# Autodesk Inventor assembly: MontagemCanhao
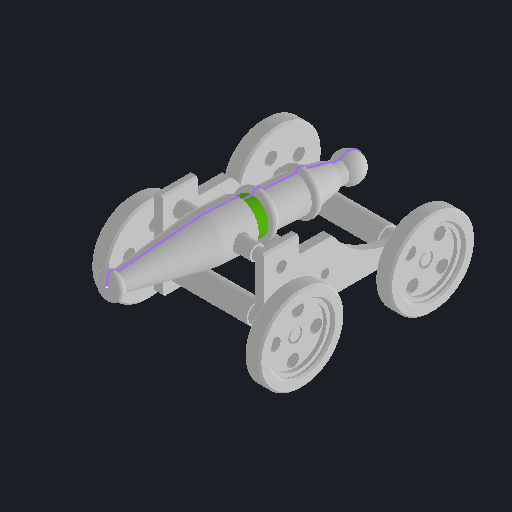
[picture p0: Inventor's stored thumbnail of the model, 512x512]
Saved by Autodesk Inventor 2027 (Build 310192060, 192F)
## iProperties
Created: 2026-11-08
Part Number: MontagemCanhao
Document SubType Name: Assembly
Designer: Giovanna Oliveira
Author: Giovanna Oliveira
## Documents named in this file (6)
- E:\IFSP\engMec\2Sem\DESENHOASSITIDO\Canhao\MontagemCanhao.iam
- E:\IFSP\engMec\2Sem\DESENHOASSITIDO\Canhao\Placa.ipt
- E:\IFSP\engMec\2Sem\DESENHOASSITIDO\Canhao\Peça3.ipt
- E:\IFSP\engMec\2Sem\DESENHOASSITIDO\Canhao\Eixo5.ipt
- C:\Users\Giovanna Oliveira\Downloads\canhazinho (1).ipt
- E:\IFSP\engMec\2Sem\DESENHOASSITIDO\Canhao\Roda.ipt
## Components (11 placed, 5 different names)
1. Placa:1 — Coincidente:1, Coincidente:2, Coincidente:3, Coincidente:4, Coincidente:7, Coincidente:8, Coincidente:9, Coincidente:10, Coincidente:12
2. Peça3:1 — Coincidente:1, Coincidente:3, Coincidente:13, Coincidente:14, Coincidente:16, Coincidente:17, Alinhado:1, Coincidente:19, Alinhado:3
3. Peça3:2 — Coincidente:2, Coincidente:4, Coincidente:15, Coincidente:18, Alinhado:2, Coincidente:20, Alinhado:4
4. Eixo5:1 — Coincidente:7, Coincidente:8, Coincidente:11
5. Eixo5:2 — Coincidente:9, Coincidente:10, Tangente:1
6. canhazinho (1):1 — Coincidente:11, Coincidente:12, Tangente:1
7. Placa:2 — Coincidente:13, Coincidente:14, Coincidente:15
8. Roda:1 — Coincidente:19, Alinhado:3
9. Roda:2 — Coincidente:20, Alinhado:4
10. Roda:3 — Coincidente:18, Alinhado:2
11. Roda:4 — Coincidente:16, Coincidente:17, Alinhado:1
## Relationships (23: Mate 18, Flush 4, Tangent 1)
- Coincidente:1 [Mate]: Placa:1 ↔ Peça3:1
- Coincidente:2 [Mate]: Placa:1 ↔ Peça3:2
- Coincidente:3 [Mate]: Placa:1 ↔ Peça3:1
- Coincidente:4 [Mate]: Placa:1 ↔ Peça3:2
- Coincidente:7 [Mate]: Placa:1 ↔ Eixo5:1
- Coincidente:8 [Mate]: Placa:1 ↔ Eixo5:1
- Coincidente:9 [Mate]: Placa:1 ↔ Eixo5:2
- Coincidente:10 [Mate]: Placa:1 ↔ Eixo5:2
- Coincidente:11 [Mate]: Eixo5:1 ↔ canhazinho (1):1
- Coincidente:12 [Mate] (22.5 mm): Placa:1 ↔ canhazinho (1):1
- Tangente:1: Eixo5:2 ↔ canhazinho (1):1
- Coincidente:13 [Mate]: Peça3:1 ↔ Placa:2
- Coincidente:14 [Mate]: Peça3:1 ↔ Placa:2
- Coincidente:15 [Mate]: Peça3:2 ↔ Placa:2
- Coincidente:16 [Mate]: Peça3:1 ↔ Roda:4
- Coincidente:17 [Mate]: Peça3:1 ↔ Roda:4
- Alinhado:1 [Flush]: Peça3:1 ↔ Roda:4
- Coincidente:18 [Mate]: Peça3:2 ↔ Roda:3
- Alinhado:2 [Flush]: Peça3:2 ↔ Roda:3
- Coincidente:19 [Mate]: Peça3:1 ↔ Roda:1
- Alinhado:3 [Flush]: Peça3:1 ↔ Roda:1
- Coincidente:20 [Mate]: Peça3:2 ↔ Roda:2
- Alinhado:4 [Flush]: Peça3:2 ↔ Roda:2
